# Autodesk Inventor assembly: Porca perfil de alumínio
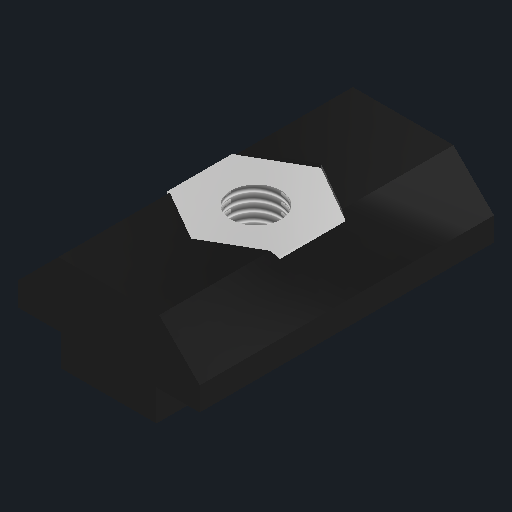
[picture p0: Inventor's stored thumbnail of the model, 512x512]
Saved by Autodesk Inventor 2026.1 (Build 301233000, 233)
## iProperties
Created: 2025-01-14
Part Number: Porca perfil de alumínio
Document SubType Name: Assembly
Designer: Cliente
Mass: 1.22075 g
Surface Area: 7.64958 cm^2
Volume: 0.680856 cm^3
Density: 1.79297 g/cm^3
Author: Cliente
## Documents named in this file (3)
- C:\Users\Cliente\Desktop\TCC\Fixação\Porca perfil de alumínio.iam
- C:\Users\Cliente\Desktop\TCC\Base\Impresso\Porca perfil de alumínio.ipt
- C:\Users\Cliente\Desktop\TCC\Fixação\Porca 2,9mm baixa.ipt
## Components (2 placed, 2 different names)
1. Porca perfil de alumínio:1 — Alinhado:1, Alinhado:2, Alinhado:3, Coincidente:1, Ângulo:1, Coincidente:2
2. Porca 2,9mm baixa:1 — Coincidente:1, Ângulo:1, Coincidente:2
## Relationships (6: Flush 3, Mate 2, Angle 1)
- Alinhado:1 [Flush]: Porca perfil de alumínio:1
- Alinhado:2 [Flush]: Porca perfil de alumínio:1
- Alinhado:3 [Flush]: Porca perfil de alumínio:1
- Coincidente:1 [Mate]: Porca perfil de alumínio:1 ↔ Porca 2,9mm baixa:1
- Ângulo:1 [Angle] (0 deg): Porca perfil de alumínio:1 ↔ Porca 2,9mm baixa:1
- Coincidente:2 [Mate]: Porca perfil de alumínio:1 ↔ Porca 2,9mm baixa:1
